# Autodesk Inventor assembly: SCARA_V1
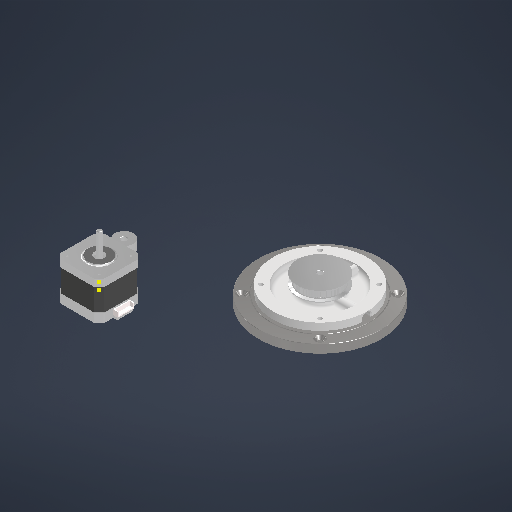
[picture p0: Inventor's stored thumbnail of the model, 512x512]
Saved by Autodesk Inventor 2026.2 (Build 302298010, 298A)
## iProperties
Created: 2026-05-09
Part Number: SCARA_V1
Document SubType Name: Assembly
Designer: work
Author: work
## Documents named in this file (6)
- C:\Users\work\Desktop\ARD_v1\ARD_hardware\SCARA_v1\SCARA_V1.iam
- C:\Users\work\Desktop\ARD_v1\ARD_hardware\SCARA_v1\Front-Wheel Bracket.ipt
- C:\Users\work\Desktop\ARD_v1\ARD_hardware\SCARA_v1\Object\24 Timing Belt Pulli.ipt
- C:\Users\work\Desktop\ARD_v1\ARD_hardware\SCARA_v1\Object\48 Timing Belt Pulli.ipt
- C:\Users\work\Desktop\ARD_v1\ARD_hardware\SCARA_v1\Object\120PI Turntable.ipt
- C:\Users\work\Desktop\ARD_v1\ARD_hardware\SCARA_v1\Object\NEMA17.ipt
## Components (5 placed, 5 different names)
1. Front-Wheel Bracket:1 — 메이트:1, 메이트:2, 메이트:3, 메이트:4, 메이트:5
2. 24 Timing Belt Pulli:1
3. 48 Timing Belt Pulli:1 — 메이트:3, 메이트:4
4. 120PI Turntable:1 — 메이트:1, 메이트:2, 메이트:5
5. NEMA17:1
## Relationships (5: Mate 5)
- 메이트:1 [Mate]: Front-Wheel Bracket:1 ↔ 120PI Turntable:1
- 메이트:2 [Mate]: Front-Wheel Bracket:1 ↔ 120PI Turntable:1
- 메이트:3 [Mate]: Front-Wheel Bracket:1 ↔ 48 Timing Belt Pulli:1
- 메이트:4 [Mate]: Front-Wheel Bracket:1 ↔ 48 Timing Belt Pulli:1
- 메이트:5 [Mate]: Front-Wheel Bracket:1 ↔ 120PI Turntable:1
